# Autodesk Inventor assembly: 部件12
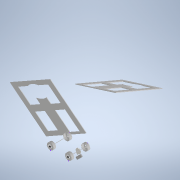
[picture p0: Inventor's stored thumbnail of the model, 180x180]
Saved by Autodesk Inventor 2021 (Build 250183000, 183)
## iProperties
Created: 2024-05-15
Part Number: 部件12
Document SubType Name: Assembly
Designer: admin
Author: admin
## Documents named in this file (4)
- E:\月球车模型-许诺\部件12.iam
- C:\Users\admin\Desktop\月球车模型-姓名\车轮车轴组合.iam
- C:\Users\admin\Desktop\月球车模型-姓名\蜗轮蜗杆传动.iam
- C:\Users\admin\Desktop\月球车模型-姓名\雪弗板（0.3×20×30cm）每组1份.ipt
## Components (5 placed, 3 different names)
1. 车轮车轴组合:1 [sub-assembly] — 刚性:1, 配合:1
2. 车轮车轴组合:2 [sub-assembly] — 配合:1
3. 蜗轮蜗杆传动:1 [sub-assembly] — 刚性:1
4. 雪弗板（0.3×20×30cm）每组1份:1
5. 雪弗板（0.3×20×30cm）每组1份:2
## Relationships (2: WeldJoint 1, Mate 1)
- 刚性:1 [WeldJoint]: 车轮车轴组合:1 ↔ 蜗轮蜗杆传动:1
- 配合:1 [Mate] (100 mm): 车轮车轴组合:1 ↔ 车轮车轴组合:2
